# Autodesk Inventor assembly: base soldada
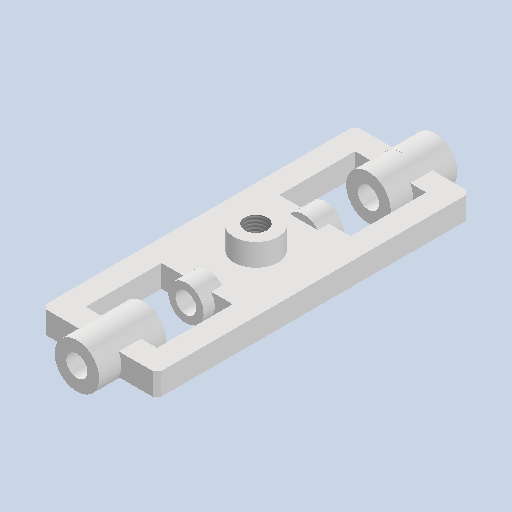
[picture p0: Inventor's stored thumbnail of the model, 512x512]
Saved by Autodesk Inventor 2025.2 (Build 292293000, 293)
## iProperties
Created: 2025-03-23
Part Number: base soldada
Document SubType Name: Assembly
Designer: laura
Author: laura
## Documents named in this file (7)
- C:\Users\laura\OneDrive - Universidad de los andes\Documentos\7mo semestre\Principios de Mecanizado\base soldada.iam
- C:\Users\laura\OneDrive - Universidad de los andes\Documentos\7mo semestre\Principios de Mecanizado\base.ipt
- C:\Users\laura\OneDrive - Universidad de los andes\Documentos\7mo semestre\Principios de Mecanizado\cilindro_base.ipt
- C:\Users\laura\OneDrive - Universidad de los andes\Documentos\7mo semestre\Principios de Mecanizado\cilindro_ext_interferencia.ipt
- C:\Users\laura\OneDrive - Universidad de los andes\Documentos\7mo semestre\Principios de Mecanizado\cilindro_ext_pasante.ipt
- C:\Users\laura\OneDrive - Universidad de los andes\Documentos\7mo semestre\Principios de Mecanizado\cilindro_int_interferencia.ipt
- C:\Users\laura\OneDrive - Universidad de los andes\Documentos\7mo semestre\Principios de Mecanizado\cilindro_int_pasante.ipt
## Components (6 placed, 6 different names)
1. base:1 — Rigid:1, Rigid:2, Rigid:3, Rigid:4, Rigid:5
2. cilindro_base:1 — Rigid:3
3. cilindro_ext_interferencia:1 — Rigid:1
4. cilindro_ext_pasante:1 — Rigid:5
5. cilindro_int_interferencia:1 — Rigid:2
6. cilindro_int_pasante:1 — Rigid:4
## Relationships (5: WeldJoint 5)
- Rigid:1 [WeldJoint]: base:1 ↔ cilindro_ext_interferencia:1
- Rigid:2 [WeldJoint]: base:1 ↔ cilindro_int_interferencia:1
- Rigid:3 [WeldJoint]: base:1 ↔ cilindro_base:1
- Rigid:4 [WeldJoint]: base:1 ↔ cilindro_int_pasante:1
- Rigid:5 [WeldJoint]: base:1 ↔ cilindro_ext_pasante:1
